# Autodesk Inventor assembly: assemble_1
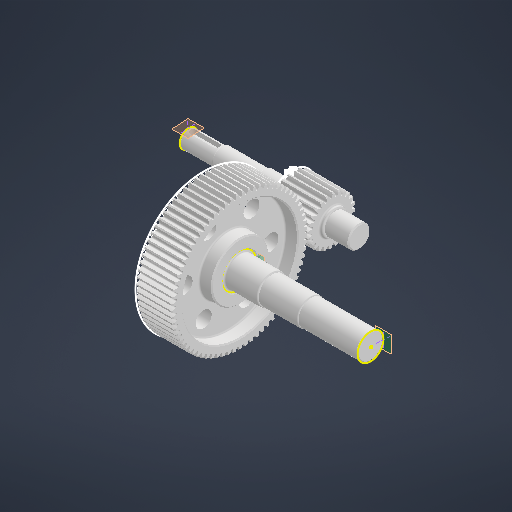
[picture p0: Inventor's stored thumbnail of the model, 512x512]
Saved by Autodesk Inventor 2026 (Build 300175000, 175)
## iProperties
Created: 2026-08-27
Part Number: assemble_1
Document SubType Name: Assembly
Designer: 14170
Author: 14170
## Documents named in this file (5)
- C:\Users\14170\Desktop\研究生课题\test\reducer\assemble_1.iam
- C:\Users\14170\Desktop\研究生课题\test\reducer\高速轴.ipt
- C:\Users\14170\Desktop\研究生课题\test\reducer\低速轴.ipt
- C:\Users\14170\Desktop\研究生课题\test\reducer\低速大齿轮.ipt
- C:\Users\14170\Desktop\研究生课题\test\reducer\assemble\设计加速器\键联接1.iam
## Components (4 placed, 4 different names)
1. 高速轴:1
2. 低速轴:1 — 配合:6, 刚性:1, 旋转:1
3. 低速大齿轮:1 — 配合:6, 旋转:1
4. 键联接:1 [sub-assembly] — 刚性:1
## Relationships (3: Mate 1, WeldJoint 1, RevoluteJoint 1)
- 配合:6 [Mate]: 低速轴:1 ↔ 低速大齿轮:1
- 刚性:1 [WeldJoint]: 低速轴:1 ↔ 键联接:1
- 旋转:1 [RevoluteJoint]: 低速轴:1 ↔ 低速大齿轮:1
